# Autodesk Inventor assembly: S3v2
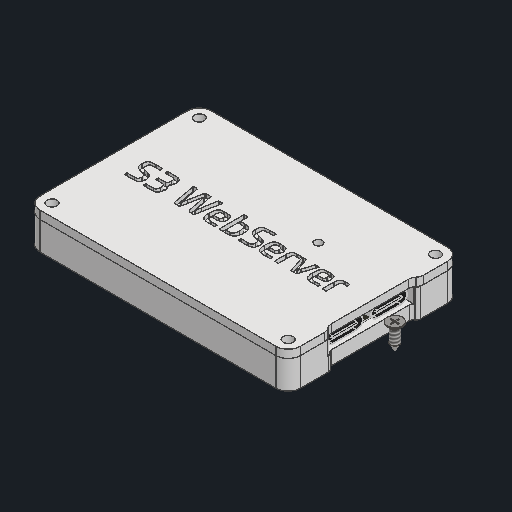
[picture p0: Inventor's stored thumbnail of the model, 512x512]
Saved by Autodesk Inventor 2027 (Build 310192000, 192)
## iProperties
Created: 2026-09-27
Part Number: S3v2
Document SubType Name: Assembly
Designer: work
Author: work
## Documents named in this file (5)
- C:\Users\khw\Desktop\Mini WebServer\CAD Models\S3_V4\S3v2.iam
- C:\Users\khw\Desktop\Mini WebServer\CAD Models\S3_V4\COVER.ipt
- C:\Users\khw\Desktop\Mini WebServer\CAD Models\S3_V4\ESP32-S3.ipt
- C:\Users\khw\Desktop\Mini WebServer\CAD Models\S3_V4\CASE.ipt
- C:\Users\khw\Desktop\Mini WebServer\CAD Models\S3_V4\JIS B 1122 - ST2.2 x 6.5 - C - H(1).ipt
## Components (4 placed, 4 different names)
1. COVER:1 — 메이트:4, 메이트:5, 메이트:6, 삽입:2
2. ESP32-S3:1 — 메이트:1, 메이트:2, 메이트:3
3. CASE:1 — 메이트:1, 메이트:2, 메이트:3, 메이트:4, 메이트:5, 메이트:6
4. JIS B 1122 - ST2.2 x 6.5 - C - H(1):2 — 삽입:2
## Relationships (7: Mate 6, Insert 1)
- 메이트:1 [Mate]: ESP32-S3:1 ↔ CASE:1
- 메이트:2 [Mate]: ESP32-S3:1 ↔ CASE:1
- 메이트:3 [Mate] (0.5 mm): ESP32-S3:1 ↔ CASE:1
- 메이트:4 [Mate]: COVER:1 ↔ CASE:1
- 메이트:5 [Mate]: COVER:1 ↔ CASE:1
- 메이트:6 [Mate]: COVER:1 ↔ CASE:1
- 삽입:2 [Insert]: COVER:1 ↔ JIS B 1122 - ST2.2 x 6.5 - C - H(1):2
